# Autodesk Inventor assembly: SPE4V1 Acrilico Paciente
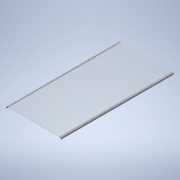
[picture p0: Inventor's stored thumbnail of the model, 180x180]
Saved by Autodesk Inventor 2021.2 (Build 252289000, 289)
## iProperties
Created: 2026-08-25
Part Number: SPE4V1 Acrilico Paciente
Document SubType Name: Assembly
Designer: nelso
Author: nelso
## Documents named in this file (9)
- C:\Users\nelso\Documents\Escritorio\Soporte-Paciente-Espinografia\Workspace\SPE4V1 Acrilico Paciente.iam
- C:\Users\nelso\Documents\Escritorio\Soporte-Paciente-Espinografia\Workspace\SP46V1 Acrilico.ipt
- C:\Users\nelso\Documents\Escritorio\Soporte-Paciente-Espinografia\Workspace\SP47V1 Seguro Acrilico.ipt
- C:\Users\nelso\Documents\Escritorio\Soporte-Paciente-Espinografia\Workspace\SP48V1 Chapa Acrilico.ipt
- C:\Users\nelso\Documents\Escritorio\Soporte-Paciente-Espinografia\Workspace\DIN555-5M4X0.8I.ipt
- C:\Users\nelso\Documents\Escritorio\Soporte-Paciente-Espinografia\Workspace\DIN125A4C.ipt
- C:\Users\nelso\Documents\Escritorio\Soporte-Paciente-Espinografia\Workspace\SP49V1 Chapa Acrilico Pasador.ipt
- C:\Users\nelso\Documents\Escritorio\Soporte-Paciente-Espinografia\Workspace\ISO7380M4X0.8L20I.ipt
- C:\Users\nelso\Documents\Escritorio\Soporte-Paciente-Espinografia\Workspace\SP57V1 Seguro Acrilico Pasador.ipt
## Components (56 placed, 8 different names)
1. SP46V1 Acrilico:1 — Mate:114, Mate:116, Mate:119, Mate:122, Mate:123
2. SP47V1 Seguro Acrilico:1
3. SP57V1 Seguro Acrilico Pasador:1 — Mate:119, Mate:120, Mate:121, Mate:124, Mate:125
4. SP48V1 Chapa Acrilico:1 — Mate:113, Mate:115
5. SP49V1 Chapa Acrilico Pasador:1 — Mate:116, Mate:117, Mate:118
6. ISO7380M4X0.8L20I:1 — Mate:117, Mate:121, Mate:122, Mate:124
7. ISO7380M4X0.8L20I:2
8. ISO7380M4X0.8L20I:3
9. ISO7380M4X0.8L20I:4
10. ISO7380M4X0.8L20I:5
11. ISO7380M4X0.8L20I:6
12. ISO7380M4X0.8L20I:7
13. ISO7380M4X0.8L20I:8 — Mate:118, Mate:120, Mate:123, Mate:125
14. ISO7380M4X0.8L20I:9 — Mate:113, Mate:114
15. ISO7380M4X0.8L20I:10
16. ISO7380M4X0.8L20I:11
17. ISO7380M4X0.8L20I:12
18. ISO7380M4X0.8L20I:13
19. ISO7380M4X0.8L20I:14
20. ISO7380M4X0.8L20I:15
21. ISO7380M4X0.8L20I:16 — Mate:115
22. ISO7380M4X0.8L20I:17
23. DIN555-5M4X0.8I:1
24. DIN555-5M4X0.8I:2
25. DIN555-5M4X0.8I:3
26. DIN555-5M4X0.8I:4
27. DIN555-5M4X0.8I:5
28. DIN555-5M4X0.8I:7
29. DIN555-5M4X0.8I:8
30. DIN555-5M4X0.8I:9
31. DIN555-5M4X0.8I:10
32. DIN555-5M4X0.8I:11
33. DIN555-5M4X0.8I:12
34. DIN555-5M4X0.8I:13
35. DIN555-5M4X0.8I:14
36. DIN555-5M4X0.8I:15
37. DIN555-5M4X0.8I:16
38. DIN555-5M4X0.8I:17
39. DIN555-5M4X0.8I:18
40. DIN125A4C:1
41. DIN125A4C:2
42. DIN125A4C:3
43. DIN125A4C:4
44. DIN125A4C:5
45. DIN125A4C:7
46. DIN125A4C:8
47. DIN125A4C:9
48. DIN125A4C:10
49. DIN125A4C:11
50. DIN125A4C:12
51. DIN125A4C:13
52. DIN125A4C:14
53. DIN125A4C:15
54. DIN125A4C:16
55. DIN125A4C:17
56. DIN125A4C:18
## Relationships (94: Mate 93, Flush 1)
- [Mate]: SP46V1 Acrilico:1 ↔ SP47V1 Seguro Acrilico:1
- [Flush]: SP46V1 Acrilico:1 ↔ SP47V1 Seguro Acrilico:1
- [Mate]: SP47V1 Seguro Acrilico:1 ↔ ISO7380M4X0.8L20I:9
- [Mate]: SP47V1 Seguro Acrilico:1 ↔ ISO7380M4X0.8L20I:10
- [Mate]: SP47V1 Seguro Acrilico:1 ↔ ISO7380M4X0.8L20I:11
- [Mate]: SP47V1 Seguro Acrilico:1 ↔ ISO7380M4X0.8L20I:12
- [Mate]: SP47V1 Seguro Acrilico:1 ↔ ISO7380M4X0.8L20I:13
- [Mate]: SP47V1 Seguro Acrilico:1 ↔ ISO7380M4X0.8L20I:17
- [Mate]: SP47V1 Seguro Acrilico:1 ↔ ISO7380M4X0.8L20I:14
- [Mate]: SP47V1 Seguro Acrilico:1 ↔ ISO7380M4X0.8L20I:15
- [Mate]: SP47V1 Seguro Acrilico:1 ↔ ISO7380M4X0.8L20I:16
- [Mate]: SP47V1 Seguro Acrilico:1 ↔ ISO7380M4X0.8L20I:15
- [Mate]: SP47V1 Seguro Acrilico:1 ↔ ISO7380M4X0.8L20I:14
- [Mate]: SP47V1 Seguro Acrilico:1 ↔ ISO7380M4X0.8L20I:17
- [Mate]: SP47V1 Seguro Acrilico:1 ↔ ISO7380M4X0.8L20I:13
- [Mate]: SP47V1 Seguro Acrilico:1 ↔ ISO7380M4X0.8L20I:12
- [Mate]: SP47V1 Seguro Acrilico:1 ↔ ISO7380M4X0.8L20I:10
- [Mate]: SP46V1 Acrilico:1 ↔ SP48V1 Chapa Acrilico:1
- [Mate]: ISO7380M4X0.8L20I:1 ↔ DIN555-5M4X0.8I:1
- [Mate]: ISO7380M4X0.8L20I:2 ↔ DIN555-5M4X0.8I:2
- [Mate]: ISO7380M4X0.8L20I:3 ↔ DIN555-5M4X0.8I:3
- [Mate]: ISO7380M4X0.8L20I:4 ↔ DIN555-5M4X0.8I:4
- [Mate]: ISO7380M4X0.8L20I:5 ↔ DIN555-5M4X0.8I:5
- [Mate]: ISO7380M4X0.8L20I:6 ↔ DIN555-5M4X0.8I:7
- [Mate]: ISO7380M4X0.8L20I:7 ↔ DIN555-5M4X0.8I:8
- [Mate]: ISO7380M4X0.8L20I:8 ↔ DIN555-5M4X0.8I:9
- [Mate]: ISO7380M4X0.8L20I:9 ↔ DIN555-5M4X0.8I:10
- [Mate]: ISO7380M4X0.8L20I:10 ↔ DIN555-5M4X0.8I:11
- [Mate]: ISO7380M4X0.8L20I:11 ↔ DIN555-5M4X0.8I:12
- [Mate]: ISO7380M4X0.8L20I:12 ↔ DIN555-5M4X0.8I:13
- [Mate]: ISO7380M4X0.8L20I:13 ↔ DIN555-5M4X0.8I:14
- [Mate]: ISO7380M4X0.8L20I:17 ↔ DIN555-5M4X0.8I:15
- [Mate]: ISO7380M4X0.8L20I:14 ↔ DIN555-5M4X0.8I:16
- [Mate]: ISO7380M4X0.8L20I:15 ↔ DIN555-5M4X0.8I:17
- [Mate]: ISO7380M4X0.8L20I:16 ↔ DIN555-5M4X0.8I:18
- [Mate]: ISO7380M4X0.8L20I:9 ↔ DIN125A4C:18
- [Mate]: ISO7380M4X0.8L20I:10 ↔ DIN125A4C:17
- [Mate]: ISO7380M4X0.8L20I:11 ↔ DIN125A4C:16
- [Mate]: ISO7380M4X0.8L20I:12 ↔ DIN125A4C:15
- [Mate]: ISO7380M4X0.8L20I:13 ↔ DIN125A4C:14
- [Mate]: ISO7380M4X0.8L20I:17 ↔ DIN125A4C:13
- [Mate]: ISO7380M4X0.8L20I:14 ↔ DIN125A4C:12
- [Mate]: ISO7380M4X0.8L20I:16 ↔ DIN125A4C:11
- [Mate]: ISO7380M4X0.8L20I:15 ↔ DIN125A4C:10
- [Mate]: ISO7380M4X0.8L20I:8 ↔ DIN125A4C:9
- [Mate]: ISO7380M4X0.8L20I:7 ↔ DIN125A4C:8
- [Mate]: ISO7380M4X0.8L20I:6 ↔ DIN125A4C:7
- [Mate]: ISO7380M4X0.8L20I:5 ↔ DIN125A4C:5
- [Mate]: ISO7380M4X0.8L20I:4 ↔ DIN125A4C:4
- [Mate]: ISO7380M4X0.8L20I:3 ↔ DIN125A4C:3
- [Mate]: ISO7380M4X0.8L20I:2 ↔ DIN125A4C:2
- [Mate]: ISO7380M4X0.8L20I:1 ↔ DIN125A4C:1
- [Mate]: DIN555-5M4X0.8I:1 ↔ DIN125A4C:1
- [Mate]: DIN555-5M4X0.8I:2 ↔ DIN125A4C:2
- [Mate]: DIN555-5M4X0.8I:3 ↔ DIN125A4C:3
- [Mate]: DIN555-5M4X0.8I:4 ↔ DIN125A4C:4
- [Mate]: DIN555-5M4X0.8I:5 ↔ DIN125A4C:5
- [Mate]: DIN555-5M4X0.8I:7 ↔ DIN125A4C:7
- [Mate]: DIN555-5M4X0.8I:8 ↔ DIN125A4C:8
- [Mate]: DIN555-5M4X0.8I:9 ↔ DIN125A4C:9
- [Mate]: SP48V1 Chapa Acrilico:1 ↔ DIN125A4C:11
- [Mate]: DIN555-5M4X0.8I:18 ↔ DIN125A4C:11
- [Mate]: SP48V1 Chapa Acrilico:1 ↔ DIN125A4C:10
- [Mate]: DIN555-5M4X0.8I:17 ↔ DIN125A4C:10
- [Mate]: SP48V1 Chapa Acrilico:1 ↔ DIN125A4C:12
- [Mate]: DIN555-5M4X0.8I:16 ↔ DIN125A4C:12
- [Mate]: SP48V1 Chapa Acrilico:1 ↔ DIN125A4C:13
- [Mate]: DIN555-5M4X0.8I:15 ↔ DIN125A4C:13
- [Mate]: SP48V1 Chapa Acrilico:1 ↔ DIN125A4C:14
- [Mate]: DIN555-5M4X0.8I:14 ↔ DIN125A4C:14
- [Mate]: SP48V1 Chapa Acrilico:1 ↔ DIN125A4C:15
- [Mate]: DIN555-5M4X0.8I:13 ↔ DIN125A4C:15
- [Mate]: SP48V1 Chapa Acrilico:1 ↔ DIN125A4C:16
- [Mate]: DIN555-5M4X0.8I:12 ↔ DIN125A4C:16
- [Mate]: SP48V1 Chapa Acrilico:1 ↔ DIN125A4C:17
- [Mate]: DIN555-5M4X0.8I:11 ↔ DIN125A4C:17
- [Mate]: SP48V1 Chapa Acrilico:1 ↔ DIN125A4C:18
- [Mate]: DIN555-5M4X0.8I:10 ↔ DIN125A4C:18
- [Mate]: SP47V1 Seguro Acrilico:1 ↔ ISO7380M4X0.8L20I:16
- [Mate]: SP47V1 Seguro Acrilico:1 ↔ ISO7380M4X0.8L20I:9
- [Mate]: SP47V1 Seguro Acrilico:1 ↔ ISO7380M4X0.8L20I:11
- Mate:113: SP48V1 Chapa Acrilico:1 ↔ ISO7380M4X0.8L20I:9
- Mate:114: SP46V1 Acrilico:1 ↔ ISO7380M4X0.8L20I:9
- Mate:115: SP48V1 Chapa Acrilico:1 ↔ ISO7380M4X0.8L20I:16
- Mate:116: SP46V1 Acrilico:1 ↔ SP49V1 Chapa Acrilico Pasador:1
- Mate:117: SP49V1 Chapa Acrilico Pasador:1 ↔ ISO7380M4X0.8L20I:1
- Mate:118: SP49V1 Chapa Acrilico Pasador:1 ↔ ISO7380M4X0.8L20I:8
- Mate:119: SP46V1 Acrilico:1 ↔ SP57V1 Seguro Acrilico Pasador:1
- Mate:120: SP57V1 Seguro Acrilico Pasador:1 ↔ ISO7380M4X0.8L20I:8
- Mate:121: SP57V1 Seguro Acrilico Pasador:1 ↔ ISO7380M4X0.8L20I:1
- Mate:122: SP46V1 Acrilico:1 ↔ ISO7380M4X0.8L20I:1
- Mate:123: SP46V1 Acrilico:1 ↔ ISO7380M4X0.8L20I:8
- Mate:124: SP57V1 Seguro Acrilico Pasador:1 ↔ ISO7380M4X0.8L20I:1
- Mate:125: SP57V1 Seguro Acrilico Pasador:1 ↔ ISO7380M4X0.8L20I:8
